# Autodesk Inventor assembly: zespol_silnik_i_reduktor
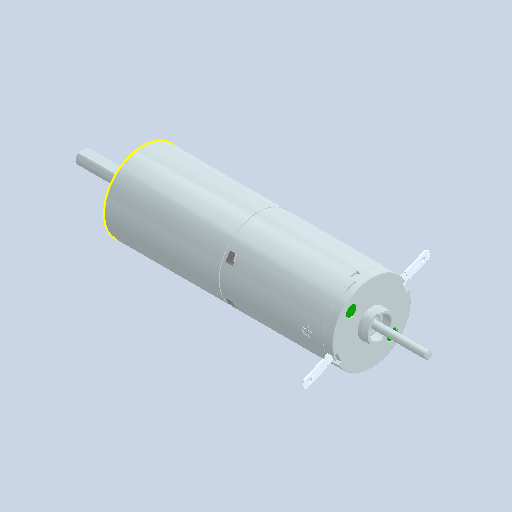
[picture p0: Inventor's stored thumbnail of the model, 512x512]
Saved by Autodesk Inventor 2025.2 (Build 292293000, 293)
## iProperties
Created: 2025-04-06
Part Number: zespol_silnik_i_reduktor
Document SubType Name: Assembly
Designer: makst
Author: makst
## Documents named in this file (3)
- C:\Users\makst\OneDrive\Dokumenty\Inventor\ZNL\zespol_silnik_i_reduktor.iam
- C:\ZNL\silnik\reduktor\reduktor.ipt
- C:\ZNL\silnik\silnik\silnik.ipt
## Components (2 placed, 2 different names)
1. reduktor:1 — Mate:1, Mate:2
2. silnik:1 — Mate:1, Mate:2
## Relationships (2: Mate 2)
- Mate:1: reduktor:1 ↔ silnik:1
- Mate:2: reduktor:1 ↔ silnik:1
